# Autodesk Inventor assembly: RDS-0000 Reagent Dosing Station
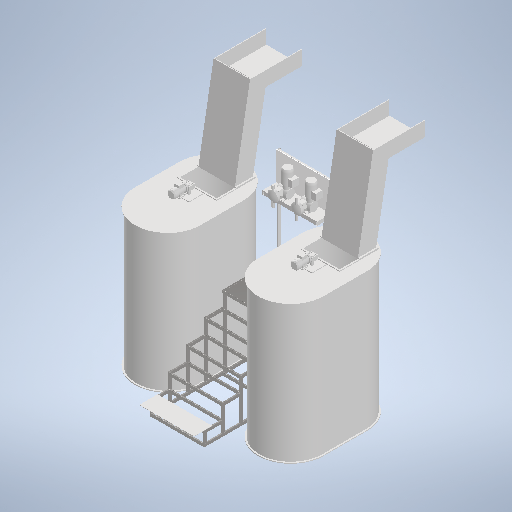
[picture p0: Inventor's stored thumbnail of the model, 512x512]
Saved by Autodesk Inventor 2026 (Build 300175000, 175)
## iProperties
Created: 2026-10-12
Part Number: RDS-0000 Reagent Dosing Station
Description: Reagent dosing station
Document SubType Name: Assembly
Designer: admin
Stock Number: Станция дозирования реагента, 2 емкости 2 м3 Парфино
Author: admin
## Documents named in this file (13)
- C:\Users\user\Documents\Inventor\RDS-Reagent-Dosing-Station\RDS-0000 Reagent Dosing Station.iam
- C:\Users\user\Documents\Inventor\RDS-Reagent-Dosing-Station\Frame\RDS-2000 Platform Frame.iam
- C:\Users\user\Documents\Inventor\RDS-Reagent-Dosing-Station\Frame\RDS-2100 Panel Rack.iam
- C:\Users\user\Documents\Inventor\RDS-Reagent-Dosing-Station\Frame\RDS-3001 Deck 750x1500.ipt
- C:\Users\user\Documents\Inventor\RDS-Reagent-Dosing-Station\Tank\RDS-1000 Tank with Mixer.iam
- C:\Users\user\Documents\Inventor\RDS-Reagent-Dosing-Station\Purchased\RDS-5002 Panel Plate 750x400.ipt
- C:\Users\user\Documents\Inventor\RDS-Reagent-Dosing-Station\Purchased\RDS-5004 Receiver.ipt
- C:\Users\user\Documents\Inventor\RDS-Reagent-Dosing-Station\Purchased\RDS-5003 Solenoid Valve 3-way.ipt
- C:\Users\user\Documents\Inventor\RDS-Reagent-Dosing-Station\RDS-6000 ladder Frame.iam
- C:\Users\user\Documents\Inventor\RDS-Reagent-Dosing-Station\RDS-7000 loading.iam
- C:\Users\user\Documents\Inventor\RDS-Reagent-Dosing-Station\Frame\RDS-5005 Panel Plate 750x200.ipt
- C:\Users\user\Documents\Inventor\RDS-Reagent-Dosing-Station\Старые модели\СДР 050 Дозатор реагента.ipt
- C:\Users\user\Documents\Inventor\RDS-Reagent-Dosing-Station\RDS-7000 loading2.iam
## Components (14 placed, 12 different names)
1. RDS-2000 Platform Frame:1 [sub-assembly] — Заподлицо:1
2. RDS-2100 Panel Rack:1 [sub-assembly] — Совмещение:2, Заподлицо:5, Заподлицо:6, Жесткий:1
3. RDS-3001 Deck 750x1500:1
4. RDS-1000 Tank with Mixer:1 [sub-assembly] — Заподлицо:1, Заподлицо:2, Совмещение:1, Заподлицо:3, Заподлицо:4, Совмещение:3
5. RDS-1000 Tank with Mixer:2 [sub-assembly] — Заподлицо:2, Совмещение:4, Заподлицо:7, Совмещение:5, Жесткий:2
6. RDS-5002 Panel Plate 750x400:1
7. RDS-5004 Receiver:1
8. RDS-5003 Solenoid Valve 3-way:1
9. RDS-6000 ladder Frame:1 [sub-assembly] — Совмещение:2, Заподлицо:5, Заподлицо:6, Совмещение:3, Совмещение:4, Заподлицо:7, Совмещение:5
10. RDS-7000 loading:1 [sub-assembly] — Совмещение:1, Заподлицо:3, Заподлицо:4
11. RDS-5005 Panel Plate 750x200:1 — Жесткий:1, Совмещение:6, Совмещение:7
12. СДР 050 Дозатор реагента:1 — Совмещение:6
13. СДР 050 Дозатор реагента:2 — Совмещение:7
14. RDS-7000 loading2:1 [sub-assembly] — Жесткий:2
## Relationships (16: Flush 7, Mate 7, WeldJoint 2)
- Заподлицо:1 [Flush]: RDS-2000 Platform Frame:1 ↔ RDS-1000 Tank with Mixer:1
- Заподлицо:2 [Flush]: RDS-1000 Tank with Mixer:1 ↔ RDS-1000 Tank with Mixer:2
- Совмещение:1 [Mate]: RDS-1000 Tank with Mixer:1 ↔ RDS-7000 loading:1
- Заподлицо:3 [Flush]: RDS-1000 Tank with Mixer:1 ↔ RDS-7000 loading:1
- Заподлицо:4 [Flush]: RDS-1000 Tank with Mixer:1 ↔ RDS-7000 loading:1
- Совмещение:2 [Mate]: RDS-2100 Panel Rack:1 ↔ RDS-6000 ladder Frame:1
- Заподлицо:5 [Flush]: RDS-2100 Panel Rack:1 ↔ RDS-6000 ladder Frame:1
- Заподлицо:6 [Flush]: RDS-2100 Panel Rack:1 ↔ RDS-6000 ladder Frame:1
- Совмещение:3 [Mate] (20 mm): RDS-1000 Tank with Mixer:1 ↔ RDS-6000 ladder Frame:1
- Совмещение:4 [Mate] (-430 mm): RDS-1000 Tank with Mixer:2 ↔ RDS-6000 ladder Frame:1
- Заподлицо:7 [Flush]: RDS-1000 Tank with Mixer:2 ↔ RDS-6000 ladder Frame:1
- Совмещение:5 [Mate] (20 mm): RDS-1000 Tank with Mixer:2 ↔ RDS-6000 ladder Frame:1
- Жесткий:1 [WeldJoint]: RDS-2100 Panel Rack:1 ↔ RDS-5005 Panel Plate 750x200:1
- Совмещение:6 [Mate]: RDS-5005 Panel Plate 750x200:1 ↔ СДР 050 Дозатор реагента:1
- Совмещение:7 [Mate]: RDS-5005 Panel Plate 750x200:1 ↔ СДР 050 Дозатор реагента:2
- Жесткий:2 [WeldJoint]: RDS-1000 Tank with Mixer:2 ↔ RDS-7000 loading2:1
